# Autodesk Inventor assembly: MM0948AN100_G80_001
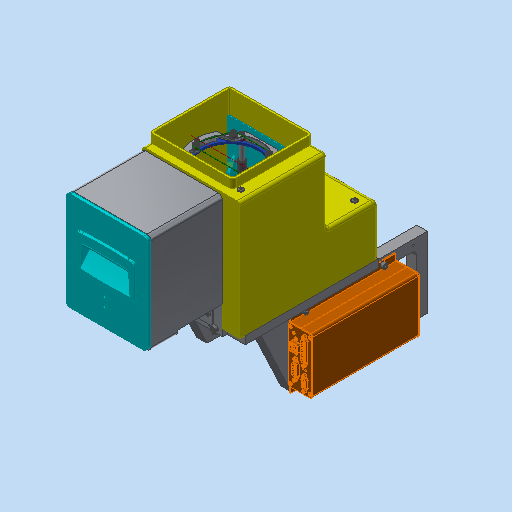
[picture p0: Inventor's stored thumbnail of the model, 512x512]
Saved by Autodesk Inventor 2023.3 (Build 273359000, 359)
## iProperties
Part Number: MM0948AN100_G80_001
Material: Generisch
Description: =<RBPARTNOTITLE2>
Document SubType Name: Assembly
Designer: FH/Wi
Mass: 22646.4 g
Surface Area: 16320.5 cm^2
Volume: 4498.02 cm^3
Density: 5.03474 g/cm^3
Created: 2023-03-23
RBCHANGEDESCRIPTION1: Erstfreigabe
RBCHANGENO1: 00
RBDOCUMENTTYPE: DRF
RBDOCUMENTVERSION: 00
RBDRAWINGMAINSCALE: 1:1
RBDRAWINGMISSINGSPEC: --
RBDRAWINGVOLUME: --
RBDSV1: 0850
RBGBDETAILS: 43274
RBGBEDGESIN1: +0,5
RBGBEDGESIN2: +0,2
RBGBEDGESOUT1: -0,3
RBGBEDGESOUT2: -0,1
RBMATERIAL: =<Material>
RBMATMEETS: --
RBMATNO: =<Part Number>
RBORGUNITRESPONSIBLE1: AnP/TEF1
RBPARTMADEOF: --
RBPARTNO: SIEHE MNR
RBPARTNOTITLE1: scale
RBPARTNOTITLE2: Waage
RBPARTSAFETYINDICATOR: --
RBSURFACE: --
RBSURFACE2: --
RBZEDGESNORM: ISO13715:2002-06
RBZGENDIMCLASS: m
RBZGENDIMNORM: ISO 2768-1:1989-11
RBZGENGEOCLASS: H
RBZGENGEONORM: ISO 2768-2:1989-11
RBZSURFACENORM: ISO13D2:2002-02
RBZTOLERANCENORM: ISO 14405-1:2010-12
AnP_Kommentar: --
MaxAbmaße: --
AnP_TemplVers: 20190222
AnP_Kategorie: 99
AnP_Material: =<Material>
Author: FH/Wi
Keywords: =<RBPARTMADEOF>
Comments: =<RBSURFACE2>
Revision Number: 01
## Documents named in this file (7)
- C:\Users\rea9an\Documents\Inventor\TCAI2412_te1910_EM\AS00000942.iam
- C:\Users\rea9an\Documents\Inventor\TCAI2412_te1910_EM\AS00000936.iam
- C:\Users\rea9an\Documents\Inventor\TCAI2412_te1910_EM\AS00000939.iam
- C:\Users\rea9an\Documents\Inventor\TCAI2412_te1910_EM\AS00000938.iam
- C:\Users\rea9an\Documents\Inventor\TCAI2412_te1910_EM\AS00000937.iam
- C:\Users\rea9an\Documents\Inventor\TCAI2412_te1910_EM\AS00000935.iam
- C:\Users\rea9an\Documents\Inventor\TCAI2412_te1910_EM\AS00000972.iam
## Components (6 placed, 6 different names)
1. AS00000936:1 [sub-assembly] — Passend:284, Passend:285
2. AS00000938:1 [sub-assembly] — Einfügen:36
3. AS00000939:1 [sub-assembly] — Einfügen:36, Passend:289
4. AS00000972:1 [sub-assembly]
5. AS00000935:1 [sub-assembly] — Winkel:3, Passend:284, Passend:285, Passend:289
6. AS00000937:1 [sub-assembly]
## Relationships (19: Mate 13, Flush 3, Insert 2, Angle 1)
- Fluchtend:1 [Flush] (783 mm)
- [Mate]: AS00000936:1 ↔ AS00000938:1
- [Mate]: AS00000938:1
- Fluchtend:5 [Flush] (135 mm)
- [Mate] (0.05 mm): AS00000936:1
- [Flush] (1217 mm): AS00000938:1
- Einfügen:36 [Insert]: AS00000938:1 ↔ AS00000939:1
- [Mate]: AS00000938:1 ↔ AS00000939:1
- [Mate]: AS00000936:1 ↔ AS00000938:1
- Winkel:3 [Angle] (0 deg): AS00000935:1
- [Mate] (193.15 mm): AS00000938:1 ↔ AS00000937:1
- [Insert]: AS00000938:1 ↔ AS00000937:1
- [Mate]: AS00000938:1 ↔ AS00000937:1
- Passend:284 [Mate]: AS00000936:1 ↔ AS00000935:1
- Passend:285 [Mate]: AS00000936:1 ↔ AS00000935:1
- [Mate]: AS00000972:1 ↔ AS00000935:1
- [Mate]: AS00000972:1 ↔ AS00000935:1
- [Mate]: AS00000972:1 ↔ AS00000935:1
- Passend:289 [Mate]: AS00000939:1 ↔ AS00000935:1
## Named parameters: d11_d16 = 0 mm
